# Autodesk Inventor assembly: 2B_set
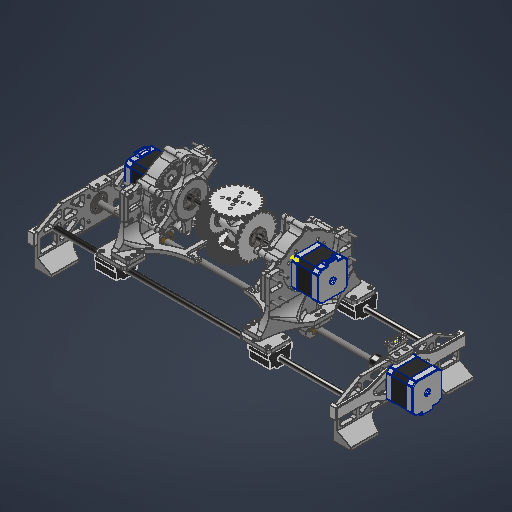
[picture p0: Inventor's stored thumbnail of the model, 512x512]
Saved by Autodesk Inventor 2026.2 (Build 302298010, 298A)
## iProperties
Created: 2026-03-18
Part Number: 2B_set
Document SubType Name: Assembly
Designer: work
Author: work
## Documents named in this file (31)
- C:\Users\work\Desktop\ARD_v1\ARD_hardware\ARD_Model_v1\2B_set_rali_v2.iam
- C:\Users\work\Desktop\ARD_v1\ARD_hardware\ARD_Model_v1\1\A.ipt
- C:\Users\work\Desktop\ARD_v1\ARD_hardware\ARD_Model_v1\C.ipt
- C:\Users\work\Desktop\ARD_v1\ARD_hardware\ARD_Model_v1\Object\JIS B 1521 SKF (D) - SKF 608-Z.ipt
- C:\Users\work\Desktop\ARD_v1\ARD_hardware\ARD_Model_v1\5_Co.ipt
- C:\Users\work\Desktop\ARD_v1\ARD_hardware\ARD_Model_v1\NEMA17.ipt
- C:\Users\work\Desktop\ARD_v1\ARD_hardware\ARD_Model_v1\1\B.ipt
- C:\Users\work\Desktop\ARD_v1\ARD_hardware\ARD_Model_v1\Object\T8_LeadNut.ipt
- C:\Users\work\Desktop\ARD_v1\ARD_hardware\ARD_Model_v1\Object\8T_Shaft.ipt
- C:\Users\work\Desktop\ARD_v1\ARD_hardware\ARD_Model_v1\Object\T8_BellowsCoulping.ipt
- C:\Users\work\Desktop\ARD_v1\ARD_hardware\ARD_Model_v1\Object\8T_ScrewShaft.ipt
- C:\Users\work\Desktop\ARD_v1\ARD_hardware\ARD_Model_v1\Object\LeadWay.ipt
- C:\Users\work\Desktop\ARD_v1\ARD_hardware\ARD_Model_v1\UR_rail_R_LinearWayCopler_v3.ipt
- C:\Users\work\Desktop\ARD_v1\ARD_hardware\ARD_Model_v1\Object\KS B 1003 - M 3 x 20.ipt
- C:\Users\work\Desktop\ARD_v1\ARD_hardware\ARD_Model_v1\Object\KS B 1003 - M 3 x 12.ipt
- C:\Users\work\Desktop\ARD_v1\ARD_hardware\PL121248m2Drive_v2\pl_v1.iam
- C:\Users\work\Desktop\ARD_v1\ARD_hardware\ARD_Model_v1\UR_rail_LeadNutHolder_v1.ipt
- C:\Users\work\Desktop\ARD_v1\ARD_hardware\Rali_v1\stand_v2.ipt
- C:\Users\work\Desktop\ARD_v1\ARD_hardware\Rali_v1\stand1.ipt
- C:\Users\work\Desktop\ARD_v1\ARD_hardware\Rali_v1\vl53_hoder.ipt
- C:\Users\work\Desktop\ARD_v1\ARD_hardware\Rali_v1\stand12.ipt
- C:\Users\work\Desktop\ARD_v1\ARD_hardware\RA_Project\VL53L0X.ipt
- C:\Users\work\Desktop\ARD_v1\ARD_hardware\ARD_Model_v1\KS B 1003 - M 3 x 12.ipt
- C:\Users\work\Desktop\ARD_v1\ARD_hardware\ARD_Model_v1\2B_set\AIP\FEA\fdflh83ds.fins
- C:\Users\work\Desktop\ARD_v1\ARD_hardware\ARD_Model_v1\2B_set\AIP\FEA\fdflh83ds.fsat
- C:\Users\work\Desktop\ARD_v1\ARD_hardware\ARD_Model_v1\2B_set\AIP\FEA\fdflh83ds.ftes
- C:\Users\work\Desktop\ARD_v1\ARD_hardware\ARD_Model_v1\2B_set\AIP\FEA\fdflh83ds.fwiz
- C:\Users\work\Desktop\ARD_v1\ARD_hardware\ARD_Model_v1\2B_set_rali\AIP\FEA\fdjqx1t5s.fins
- C:\Users\work\Desktop\ARD_v1\ARD_hardware\ARD_Model_v1\2B_set_rali\AIP\FEA\fdjqx1t5s.fsat
- C:\Users\work\Desktop\ARD_v1\ARD_hardware\ARD_Model_v1\2B_set_rali\AIP\FEA\fdjqx1t5s.ftes
- C:\Users\work\Desktop\ARD_v1\ARD_hardware\ARD_Model_v1\2B_set_rali\AIP\FEA\fdjqx1t5s.fwiz
## Components (105 placed, 21 different names)
1. JIS B 1521 SKF (D) - SKF 608-Z:5 — 메이트:118, 플러쉬:8
2. pl_v1:1 [sub-assembly] — 회전:31, 회전:32, 삽입:1, 삽입:2, 회전:33, 회전:34, 회전:35, 회전:36, 메이트:160, 메이트:163, 메이트:172
3. KS B 1003 - M 3 x 20:18 — 회전:31
4. KS B 1003 - M 3 x 20:19 — 회전:32
5. KS B 1003 - M 3 x 20:20 — 삽입:1
6. KS B 1003 - M 3 x 20:21 — 회전:34
7. KS B 1003 - M 3 x 20:22 — 삽입:2, 메이트:171
8. KS B 1003 - M 3 x 20:24 — 회전:35
9. KS B 1003 - M 3 x 20:25 — 회전:33, 메이트:170
10. KS B 1003 - M 3 x 20:26 — 회전:36
11. UR_rail_LeadNutHolder_v1:2 — 메이트:132, 메이트:133, 메이트:134, 플러쉬:10, 각도:14
12. LeadWay:5 — 메이트:156
13. UR_rail_R_LinearWayCopler_v3:5 — 메이트:181, 메이트:182
14. KS B 1003 - M 3 x 20:27
15. KS B 1003 - M 3 x 20:28
16. KS B 1003 - M 3 x 20:29
17. KS B 1003 - M 3 x 20:30
18. T8_LeadNut:3 — 메이트:187
19. KS B 1003 - M 3 x 12:9
20. KS B 1003 - M 3 x 12:10
21. KS B 1003 - M 3 x 12:11
22. KS B 1003 - M 3 x 12:12
23. LeadWay:6 — 메이트:157
24. UR_rail_R_LinearWayCopler_v3:6 — 메이트:183, 메이트:184
25. KS B 1003 - M 3 x 20:31
26. KS B 1003 - M 3 x 20:32
27. KS B 1003 - M 3 x 20:33
28. KS B 1003 - M 3 x 20:34
29. pl_v1:2 [sub-assembly] — 메이트:161, 메이트:162, 메이트:185
30. KS B 1003 - M 3 x 20:35
31. KS B 1003 - M 3 x 20:36
32. KS B 1003 - M 3 x 20:37
33. KS B 1003 - M 3 x 20:38 — 메이트:179
34. KS B 1003 - M 3 x 20:39
35. KS B 1003 - M 3 x 20:40
36. KS B 1003 - M 3 x 20:41 — 메이트:180
37. KS B 1003 - M 3 x 20:42
38. UR_rail_LeadNutHolder_v1:3 — 회전/변환:2, 플러쉬:9, 메이트:186
39. stand_v2:1 — 메이트:165, 각도:12, 메이트:166, 메이트:167, 각도:13, 각도:15, 각도:16, 메이트:188, 메이트:189, 메이트:190, 메이트:193, 삽입:25, 삽입:26, 삽입:27, 삽입:28
40. stand_v2:2 — 메이트:169, 각도:13, 플러쉬:8, 각도:15, 플러쉬:11, 메이트:195, 각도:18, 각도:19
41. stand1:1 — 메이트:170, 메이트:171, 메이트:172, 메이트:173, 메이트:174, 메이트:175, 메이트:176, 메이트:177, 메이트:178, 플러쉬:10, 각도:14, 삽입:13, 삽입:14, 삽입:15, 삽입:16, 삽입:17, 삽입:18, 삽입:19, 삽입:20
42. stand1:2 — 메이트:179, 메이트:180, 메이트:181, 메이트:182, 메이트:183, 메이트:184, 메이트:185, 플러쉬:9, 메이트:186, 각도:16, 삽입:5, 삽입:6, 삽입:7, 삽입:8, 삽입:9, 삽입:10, 삽입:11, 삽입:12
43. vl53_hoder:1 — 메이트:188, 메이트:189, 메이트:190, 메이트:198, 각도:20, 메이트:199
44. stand12:1 — 메이트:191, 메이트:192, 각도:17, 메이트:193, 메이트:194
45. stand12:2 — 메이트:195, 메이트:196, 각도:18, 메이트:197, 삽입:21, 삽입:22, 삽입:23, 삽입:24
46. VL53L0X:1 — 메이트:198, 각도:20, 메이트:199, 삽입:29, 삽입:30
47. KS B 1003 - M 3 x 12:13 — 삽입:5
48. KS B 1003 - M 3 x 12:14 — 삽입:6
49. KS B 1003 - M 3 x 12:15 — 삽입:7
50. KS B 1003 - M 3 x 12:16 — 삽입:8
51. KS B 1003 - M 3 x 12:17 — 삽입:9
52. KS B 1003 - M 3 x 12:18 — 삽입:10
53. KS B 1003 - M 3 x 12:19 — 삽입:11
54. KS B 1003 - M 3 x 12:20 — 삽입:12
55. KS B 1003 - M 3 x 12:21 — 삽입:13
56. KS B 1003 - M 3 x 12:22 — 삽입:14
57. KS B 1003 - M 3 x 12:23 — 삽입:15
58. KS B 1003 - M 3 x 12:24 — 삽입:16
59. KS B 1003 - M 3 x 12:25 — 삽입:17
60. KS B 1003 - M 3 x 12:26 — 삽입:18
61. KS B 1003 - M 3 x 12:27 — 삽입:19
62. KS B 1003 - M 3 x 12:28 — 삽입:20
63. KS B 1003 - M 3 x 12:29 — 삽입:21
64. KS B 1003 - M 3 x 12:30 — 삽입:22
65. KS B 1003 - M 3 x 12:31 — 삽입:23
66. KS B 1003 - M 3 x 12:32 — 삽입:24
67. KS B 1003 - M 3 x 12:33 — 삽입:25
68. KS B 1003 - M 3 x 12:34 — 삽입:26
69. KS B 1003 - M 3 x 12:35 — 삽입:27
70. KS B 1003 - M 3 x 12:36 — 삽입:28
71. KS B 1003 - M 3 x 12:37 — 삽입:29
72. KS B 1003 - M 3 x 12:38 — 삽입:30
73. UR_rail_R_LinearWayCopler_v3:1 — 메이트:68, 메이트:69, 메이트:70, 회전:1, 회전:2, 회전:3, 회전:4, 메이트:173, 메이트:174, 메이트:175
74. UR_rail_R_LinearWayCopler_v3:3 — 메이트:176, 메이트:177, 메이트:178
75. B:2 — 회전:3
76. A:1 — 메이트:1, 메이트:2, 메이트:11, 메이트:22, 메이트:23, 회전:1, 메이트:163
77. C:1 — 메이트:7, 메이트:8, 메이트:9, 메이트:10, 메이트:11, 메이트:27, 메이트:50, 플러쉬:3
78. A:2 — 메이트:10, 메이트:21, 메이트:24, 회전:2, 메이트:159, 메이트:162
79. 5_Co:4 — 메이트:22, 메이트:23
80. 5_Co:3 — 메이트:21, 메이트:24, 회전:3, 메이트:159, 메이트:160, 메이트:161
81. B:1 — 메이트:25, 메이트:26, 메이트:27, 회전:1, 회전:2, 각도:19
82. KS B 1003 - M 3 x 12:8 — 회전:20
83. KS B 1003 - M 3 x 12:5
84. KS B 1003 - M 3 x 12:6
85. KS B 1003 - M 3 x 12:7 — 메이트:134
86. KS B 1003 - M 3 x 20:1 — 회전:1
87. KS B 1003 - M 3 x 20:3 — 회전:3
88. KS B 1003 - M 3 x 20:4 — 회전:2
89. KS B 1003 - M 3 x 20:5 — 회전:4
90. JIS B 1521 SKF (D) - SKF 608-Z:4 — 메이트:50, 플러쉬:3
91. KS B 1003 - M 3 x 20:13
92. KS B 1003 - M 3 x 20:12
93. KS B 1003 - M 3 x 20:11
94. KS B 1003 - M 3 x 20:10
95. T8_LeadNut:2 — 회전:20, 메이트:132, 메이트:133, 메이트:158
96. 8T_Shaft:2 — 플러쉬:7, 메이트:156, 메이트:194, 메이트:197
97. LeadWay:3
98. NEMA17:3 — 메이트:110, 메이트:111, 각도:10, 각도:12, 메이트:191, 메이트:192, 각도:17
99. 8T_Shaft:1 — 메이트:71, 플러쉬:7, 메이트:157, 플러쉬:11
100. T8_BellowsCoulping:1 — 메이트:84, 메이트:85, 메이트:110, 메이트:111, 회전:4, 각도:10, 회전/변환:2
101. 8T_ScrewShaft:1 — 메이트:84, 메이트:85, 회전:4, 메이트:118, 메이트:158, 메이트:165, 메이트:169, 메이트:187, 메이트:196
102. LeadWay:1 — 메이트:68, 메이트:69, 메이트:70, 메이트:71
103. JIS B 1521 SKF (D) - SKF 608-Z:2 — 메이트:8
104. JIS B 1521 SKF (D) - SKF 608-Z:3 — 메이트:7, 메이트:25, 메이트:26
105. JIS B 1521 SKF (D) - SKF 608-Z:1 — 메이트:1, 메이트:2, 메이트:9
## Relationships (173: Mate 86, RevoluteJoint 34, Insert 30, Angle 10, Flush 6, RelateRotation 4, WeldJoint 2, RelateRotateTranslate 1)
- 메이트:1 [Mate]: A:1 ↔ JIS B 1521 SKF (D) - SKF 608-Z:1
- 메이트:2 [Mate]: A:1 ↔ JIS B 1521 SKF (D) - SKF 608-Z:1
- [Mate]: A:2 ↔ JIS B 1521 SKF (D) - SKF 608-Z:2
- [Mate]: A:2 ↔ JIS B 1521 SKF (D) - SKF 608-Z:2
- 메이트:7 [Mate]: C:1 ↔ JIS B 1521 SKF (D) - SKF 608-Z:3
- 메이트:8 [Mate]: C:1 ↔ JIS B 1521 SKF (D) - SKF 608-Z:2
- 메이트:9 [Mate]: C:1 ↔ JIS B 1521 SKF (D) - SKF 608-Z:1
- 메이트:10 [Mate]: C:1 ↔ A:2
- 메이트:11 [Mate]: A:1 ↔ C:1
- 메이트:21 [Mate]: A:2 ↔ 5_Co:3
- 메이트:22 [Mate]: A:1 ↔ 5_Co:4
- 메이트:23 [Mate]: A:1 ↔ 5_Co:4
- 메이트:24 [Mate]: A:2 ↔ 5_Co:3
- 메이트:25 [Mate]: B:1 ↔ JIS B 1521 SKF (D) - SKF 608-Z:3
- 메이트:26 [Mate]: B:1 ↔ JIS B 1521 SKF (D) - SKF 608-Z:3
- 메이트:27 [Mate]: C:1 ↔ B:1
- 회전:1 [RelateRotation] (1 ul): A:1 ↔ B:1
- 회전:2 [RelateRotation] (1 ul): A:2 ↔ B:1
- [Mate]: B:2 ↔ JIS B 1521 SKF (D) - SKF 608-Z:4
- [Mate]: B:2 ↔ JIS B 1521 SKF (D) - SKF 608-Z:4
- 메이트:50 [Mate]: C:1 ↔ JIS B 1521 SKF (D) - SKF 608-Z:4
- 플러쉬:3 [Flush]: C:1 ↔ JIS B 1521 SKF (D) - SKF 608-Z:4
- 회전:3 [RelateRotation] (1 ul): B:2 ↔ 5_Co:3
- 메이트:68 [Mate]: UR_rail_R_LinearWayCopler_v3:1 ↔ LeadWay:1
- 메이트:69 [Mate]: UR_rail_R_LinearWayCopler_v3:1 ↔ LeadWay:1
- 메이트:70 [Mate]: UR_rail_R_LinearWayCopler_v3:1 ↔ LeadWay:1
- 메이트:71 [Mate]: 8T_Shaft:1 ↔ LeadWay:1
- 회전:1 [RevoluteJoint]: UR_rail_R_LinearWayCopler_v3:1 ↔ KS B 1003 - M 3 x 20:1
- 회전:2 [RevoluteJoint]: UR_rail_R_LinearWayCopler_v3:1 ↔ KS B 1003 - M 3 x 20:4
- 회전:3 [RevoluteJoint]: UR_rail_R_LinearWayCopler_v3:1 ↔ KS B 1003 - M 3 x 20:3
- 회전:4 [RevoluteJoint]: UR_rail_R_LinearWayCopler_v3:1 ↔ KS B 1003 - M 3 x 20:5
- 메이트:84 [Mate]: T8_BellowsCoulping:1 ↔ 8T_ScrewShaft:1
- 메이트:85 [Mate] (-10 mm): T8_BellowsCoulping:1 ↔ 8T_ScrewShaft:1
- [RevoluteJoint]: KS B 1003 - M 3 x 12:5 ↔ T8_LeadNut:2
- [WeldJoint]: KS B 1003 - M 3 x 12:6 ↔ T8_LeadNut:2
- [RevoluteJoint]: KS B 1003 - M 3 x 12:7 ↔ T8_LeadNut:2
- 회전:20 [RevoluteJoint]: KS B 1003 - M 3 x 12:8 ↔ T8_LeadNut:2
- [Mate]: UR_rail_R_LinearWayCopler_v3:3 ↔ LeadWay:3
- [Mate]: UR_rail_R_LinearWayCopler_v3:3 ↔ LeadWay:3
- [Mate]: UR_rail_R_LinearWayCopler_v3:3 ↔ LeadWay:3
- [Mate]: 8T_Shaft:2 ↔ LeadWay:3
- [RevoluteJoint]: UR_rail_R_LinearWayCopler_v3:3 ↔ KS B 1003 - M 3 x 20:10
- [RevoluteJoint]: UR_rail_R_LinearWayCopler_v3:3 ↔ KS B 1003 - M 3 x 20:12
- [RevoluteJoint]: UR_rail_R_LinearWayCopler_v3:3 ↔ KS B 1003 - M 3 x 20:11
- [RevoluteJoint]: UR_rail_R_LinearWayCopler_v3:3 ↔ KS B 1003 - M 3 x 20:13
- 플러쉬:7 [Flush]: 8T_Shaft:2 ↔ 8T_Shaft:1
- 메이트:110 [Mate]: NEMA17:3 ↔ T8_BellowsCoulping:1
- 메이트:111 [Mate] (-10 mm): NEMA17:3 ↔ T8_BellowsCoulping:1
- 회전:4 [RelateRotation] (1 ul): T8_BellowsCoulping:1 ↔ 8T_ScrewShaft:1
- 각도:10 [Angle] (0 deg): NEMA17:3 ↔ T8_BellowsCoulping:1
- 메이트:118 [Mate]: JIS B 1521 SKF (D) - SKF 608-Z:5 ↔ 8T_ScrewShaft:1
- 회전:31 [RevoluteJoint]: pl_v1:1 ↔ KS B 1003 - M 3 x 20:18
- 회전:32 [RevoluteJoint]: pl_v1:1 ↔ KS B 1003 - M 3 x 20:19
- 삽입:1 [Insert]: pl_v1:1 ↔ KS B 1003 - M 3 x 20:20
- 삽입:2 [Insert]: pl_v1:1 ↔ KS B 1003 - M 3 x 20:22
- 회전:33 [RevoluteJoint]: pl_v1:1 ↔ KS B 1003 - M 3 x 20:25
- 회전:34 [RevoluteJoint]: pl_v1:1 ↔ KS B 1003 - M 3 x 20:21
- 회전:35 [RevoluteJoint]: pl_v1:1 ↔ KS B 1003 - M 3 x 20:24
- 회전:36 [RevoluteJoint]: pl_v1:1 ↔ KS B 1003 - M 3 x 20:26
- 메이트:132 [Mate]: UR_rail_LeadNutHolder_v1:2 ↔ T8_LeadNut:2
- 메이트:133 [Mate]: UR_rail_LeadNutHolder_v1:2 ↔ T8_LeadNut:2
- 메이트:134 [Mate]: UR_rail_LeadNutHolder_v1:2 ↔ KS B 1003 - M 3 x 12:7
- [Mate]: LeadWay:5 ↔ UR_rail_R_LinearWayCopler_v3:5
- [Mate]: LeadWay:5 ↔ UR_rail_R_LinearWayCopler_v3:5
- [Mate]: LeadWay:5 ↔ UR_rail_R_LinearWayCopler_v3:5
- [RevoluteJoint]: UR_rail_R_LinearWayCopler_v3:5 ↔ KS B 1003 - M 3 x 20:27
- [RevoluteJoint]: UR_rail_R_LinearWayCopler_v3:5 ↔ KS B 1003 - M 3 x 20:29
- [RevoluteJoint]: UR_rail_R_LinearWayCopler_v3:5 ↔ KS B 1003 - M 3 x 20:28
- [RevoluteJoint]: UR_rail_R_LinearWayCopler_v3:5 ↔ KS B 1003 - M 3 x 20:30
- [RevoluteJoint]: T8_LeadNut:3 ↔ KS B 1003 - M 3 x 12:9
- [WeldJoint]: T8_LeadNut:3 ↔ KS B 1003 - M 3 x 12:10
- [RevoluteJoint]: T8_LeadNut:3 ↔ KS B 1003 - M 3 x 12:11
- [RevoluteJoint]: T8_LeadNut:3 ↔ KS B 1003 - M 3 x 12:12
- [Mate]: LeadWay:6 ↔ UR_rail_R_LinearWayCopler_v3:6
- [Mate]: LeadWay:6 ↔ UR_rail_R_LinearWayCopler_v3:6
- [Mate]: LeadWay:6 ↔ UR_rail_R_LinearWayCopler_v3:6
- [RevoluteJoint]: UR_rail_R_LinearWayCopler_v3:6 ↔ KS B 1003 - M 3 x 20:31
- [RevoluteJoint]: UR_rail_R_LinearWayCopler_v3:6 ↔ KS B 1003 - M 3 x 20:33
- [RevoluteJoint]: UR_rail_R_LinearWayCopler_v3:6 ↔ KS B 1003 - M 3 x 20:32
- [RevoluteJoint]: UR_rail_R_LinearWayCopler_v3:6 ↔ KS B 1003 - M 3 x 20:34
- [RevoluteJoint]: pl_v1:2 ↔ KS B 1003 - M 3 x 20:35
- [RevoluteJoint]: pl_v1:2 ↔ KS B 1003 - M 3 x 20:36
- [Insert]: pl_v1:2 ↔ KS B 1003 - M 3 x 20:37
- [Insert]: pl_v1:2 ↔ KS B 1003 - M 3 x 20:39
- [RevoluteJoint]: pl_v1:2 ↔ KS B 1003 - M 3 x 20:41
- [RevoluteJoint]: pl_v1:2 ↔ KS B 1003 - M 3 x 20:38
- [RevoluteJoint]: pl_v1:2 ↔ KS B 1003 - M 3 x 20:40
- [RevoluteJoint]: pl_v1:2 ↔ KS B 1003 - M 3 x 20:42
- [Mate]: T8_LeadNut:3 ↔ UR_rail_LeadNutHolder_v1:3
- [Mate]: T8_LeadNut:3 ↔ UR_rail_LeadNutHolder_v1:3
- [Mate]: KS B 1003 - M 3 x 12:11 ↔ UR_rail_LeadNutHolder_v1:3
- 메이트:156 [Mate]: LeadWay:5 ↔ 8T_Shaft:2
- 메이트:157 [Mate]: LeadWay:6 ↔ 8T_Shaft:1
- 메이트:158 [Mate]: T8_LeadNut:2 ↔ 8T_ScrewShaft:1
- 메이트:159 [Mate]: A:2 ↔ 5_Co:3
- 메이트:160 [Mate]: pl_v1:1 ↔ 5_Co:3
- 메이트:161 [Mate]: pl_v1:2 ↔ 5_Co:3
- 메이트:162 [Mate]: pl_v1:2 ↔ A:2
- 메이트:163 [Mate]: pl_v1:1 ↔ A:1
- 메이트:165 [Mate]: stand_v2:1 ↔ 8T_ScrewShaft:1
- 각도:12 [Angle] (0 deg): stand_v2:1 ↔ NEMA17:3
- 메이트:166 [Mate]: stand_v2:1
- 메이트:167 [Mate]: stand_v2:1
- 메이트:169 [Mate]: stand_v2:2 ↔ 8T_ScrewShaft:1
- 각도:13 [Angle] (0 deg): stand_v2:1 ↔ stand_v2:2
- 플러쉬:8 [Flush]: JIS B 1521 SKF (D) - SKF 608-Z:5 ↔ stand_v2:2
- 회전/변환:2 [RelateRotateTranslate] (8 mm): UR_rail_LeadNutHolder_v1:3 ↔ T8_BellowsCoulping:1
- 메이트:170 [Mate]: KS B 1003 - M 3 x 20:25 ↔ stand1:1
- 메이트:171 [Mate]: KS B 1003 - M 3 x 20:22 ↔ stand1:1
- 메이트:172 [Mate]: pl_v1:1 ↔ stand1:1
- 메이트:173 [Mate]: stand1:1 ↔ UR_rail_R_LinearWayCopler_v3:1
- 메이트:174 [Mate]: stand1:1 ↔ UR_rail_R_LinearWayCopler_v3:1
- 메이트:175 [Mate]: stand1:1 ↔ UR_rail_R_LinearWayCopler_v3:1
- 메이트:176 [Mate]: stand1:1 ↔ UR_rail_R_LinearWayCopler_v3:3
- 메이트:177 [Mate]: stand1:1 ↔ UR_rail_R_LinearWayCopler_v3:3
- 메이트:178 [Mate]: stand1:1 ↔ UR_rail_R_LinearWayCopler_v3:3
- 메이트:179 [Mate]: KS B 1003 - M 3 x 20:38 ↔ stand1:2
- 메이트:180 [Mate]: KS B 1003 - M 3 x 20:41 ↔ stand1:2
- 메이트:181 [Mate]: UR_rail_R_LinearWayCopler_v3:5 ↔ stand1:2
- 메이트:182 [Mate]: UR_rail_R_LinearWayCopler_v3:5 ↔ stand1:2
- 메이트:183 [Mate]: UR_rail_R_LinearWayCopler_v3:6 ↔ stand1:2
- 메이트:184 [Mate]: UR_rail_R_LinearWayCopler_v3:6 ↔ stand1:2
- 메이트:185 [Mate]: pl_v1:2 ↔ stand1:2
- 플러쉬:9 [Flush]: UR_rail_LeadNutHolder_v1:3 ↔ stand1:2
- 메이트:186 [Mate]: UR_rail_LeadNutHolder_v1:3 ↔ stand1:2
- 메이트:187 [Mate]: T8_LeadNut:3 ↔ 8T_ScrewShaft:1
- 플러쉬:10 [Flush]: UR_rail_LeadNutHolder_v1:2 ↔ stand1:1
- 각도:14 [Angle] (0 deg): UR_rail_LeadNutHolder_v1:2 ↔ stand1:1
- 각도:15 [Angle] (0 deg): stand_v2:1 ↔ stand_v2:2
- 각도:16 [Angle] (0 deg): stand_v2:1 ↔ stand1:2
- 플러쉬:11 [Flush]: stand_v2:2 ↔ 8T_Shaft:1
- 메이트:188 [Mate]: stand_v2:1 ↔ vl53_hoder:1
- 메이트:189 [Mate]: stand_v2:1 ↔ vl53_hoder:1
- 메이트:190 [Mate]: stand_v2:1 ↔ vl53_hoder:1
- 메이트:191 [Mate]: stand12:1 ↔ NEMA17:3
- 메이트:192 [Mate]: stand12:1 ↔ NEMA17:3
- 각도:17 [Angle] (0 deg): stand12:1 ↔ NEMA17:3
- 메이트:193 [Mate]: stand_v2:1 ↔ stand12:1
- 메이트:194 [Mate]: stand12:1 ↔ 8T_Shaft:2
- 메이트:195 [Mate]: stand_v2:2 ↔ stand12:2
- 메이트:196 [Mate]: stand12:2 ↔ 8T_ScrewShaft:1
- 각도:18 [Angle] (0 deg): stand_v2:2 ↔ stand12:2
- 메이트:197 [Mate] (-32 mm): stand12:2 ↔ 8T_Shaft:2
- 각도:19 [Angle] (0 deg): stand_v2:2 ↔ B:1
- 메이트:198 [Mate]: vl53_hoder:1 ↔ VL53L0X:1
- 각도:20 [Angle] (0 deg): vl53_hoder:1 ↔ VL53L0X:1
- 메이트:199 [Mate]: vl53_hoder:1 ↔ VL53L0X:1
- 삽입:5 [Insert]: stand1:2 ↔ KS B 1003 - M 3 x 12:13
- 삽입:6 [Insert]: stand1:2 ↔ KS B 1003 - M 3 x 12:14
- 삽입:7 [Insert]: stand1:2 ↔ KS B 1003 - M 3 x 12:15
- 삽입:8 [Insert]: stand1:2 ↔ KS B 1003 - M 3 x 12:16
- 삽입:9 [Insert]: stand1:2 ↔ KS B 1003 - M 3 x 12:17
- 삽입:10 [Insert]: stand1:2 ↔ KS B 1003 - M 3 x 12:18
- 삽입:11 [Insert]: stand1:2 ↔ KS B 1003 - M 3 x 12:19
- 삽입:12 [Insert]: stand1:2 ↔ KS B 1003 - M 3 x 12:20
- 삽입:13 [Insert]: stand1:1 ↔ KS B 1003 - M 3 x 12:21
- 삽입:14 [Insert]: stand1:1 ↔ KS B 1003 - M 3 x 12:22
- 삽입:15 [Insert]: stand1:1 ↔ KS B 1003 - M 3 x 12:23
- 삽입:16 [Insert]: stand1:1 ↔ KS B 1003 - M 3 x 12:24
- 삽입:17 [Insert]: stand1:1 ↔ KS B 1003 - M 3 x 12:25
- 삽입:18 [Insert]: stand1:1 ↔ KS B 1003 - M 3 x 12:26
- 삽입:19 [Insert]: stand1:1 ↔ KS B 1003 - M 3 x 12:27
- 삽입:20 [Insert]: stand1:1 ↔ KS B 1003 - M 3 x 12:28
- 삽입:21 [Insert]: stand12:2 ↔ KS B 1003 - M 3 x 12:29
- 삽입:22 [Insert]: stand12:2 ↔ KS B 1003 - M 3 x 12:30
- 삽입:23 [Insert]: stand12:2 ↔ KS B 1003 - M 3 x 12:31
- 삽입:24 [Insert]: stand12:2 ↔ KS B 1003 - M 3 x 12:32
- 삽입:25 [Insert]: stand_v2:1 ↔ KS B 1003 - M 3 x 12:33
- 삽입:26 [Insert]: stand_v2:1 ↔ KS B 1003 - M 3 x 12:34
- 삽입:27 [Insert]: stand_v2:1 ↔ KS B 1003 - M 3 x 12:35
- 삽입:28 [Insert]: stand_v2:1 ↔ KS B 1003 - M 3 x 12:36
- 삽입:29 [Insert]: VL53L0X:1 ↔ KS B 1003 - M 3 x 12:37
- 삽입:30 [Insert]: VL53L0X:1 ↔ KS B 1003 - M 3 x 12:38
## Named parameters: d3_d1 = 0 mm, d4_d2 = 0 mm, sa_0 = 10000, d161_d108 = 0 mm, d162_d109 = 0 mm, d267_d244 = 0 mm, d268_d245 = 145.202682 deg, d269_d246 = 0 mm, d270_d249 = 0 mm, d271_d250 = -58.706613 deg, d283_d196 = 0 mm, d284_d197 = 0 mm, d285_d198 = 0 mm, d286_d199 = 0 mm, d287_d200 = 0 mm, d288_d201 = -91.486629 deg, d289_d202 = 0 mm, d290_d203 = -178.400534 deg, d291_d204 = 0 mm, d292_d205 = 61.748364 deg, d293_d206 = 0 mm, d294_d207 = 143.915054 deg, d409_d378 = 0 mm, d410_d379 = 115.892405 deg, d411_d380 = 0 mm, d412_d381 = 112.162478 deg, d413_d382 = 0 mm, d414_d383 = 0 mm, d415_d384 = 0 mm, d416_d385 = 25.874173 deg, d417_d386 = 0 mm, d418_d387 = -165.541983 deg, d419_d267_d244 = 0 mm, d420_d268_d245 = -59.964921 deg, d421_d269_d246 = 0 mm, d422_d270_d249 = 0 mm, d423_d271_d250 = -135.176355 deg, d424_d277 = 0 mm, d425_d278 = -9.563176 deg, d426_d283_d196 = 0 mm, d427_d284_d197 = 0 mm, d428_d285_d198 = 0 mm, d429_d287_d200 = 0 mm, d430_d288_d201 = -75.925419 deg, d431_d289_d202 = 0 mm, d432_d290_d203 = -132.117031 deg, d433_d291_d204 = 0 mm, d434_d292_d205 = 114.172219 deg, d435_d293_d206 = 0 mm, d436_d294_d207 = 145.141842 deg, d437_d206 = 0 mm, d438_d207 = -24.086352 deg, d439_d196 = 0 mm, d440_d197 = 0 mm, d441_d198 = 0 mm, d442_d200 = 0 mm, d443_d201 = 94.724332 deg, d444_d202 = 0 mm, d445_d203 = 161.052663 deg, d446_d204 = 0 mm, d447_d205 = -95.669645 deg, d448_d388 = 0 mm, d449_d389 = -35.870937 deg, d450_d390 = 0 mm, d451_d391 = 107.250013 deg, d458_d403 = 0 mm, d459_d404 = 0 mm, d460_d405 = 0 mm
note: some values were not read from the file. Shown as the stored number, unit unknown: "sa_0".
